# Autodesk Inventor assembly: PneumaticAirCylinder
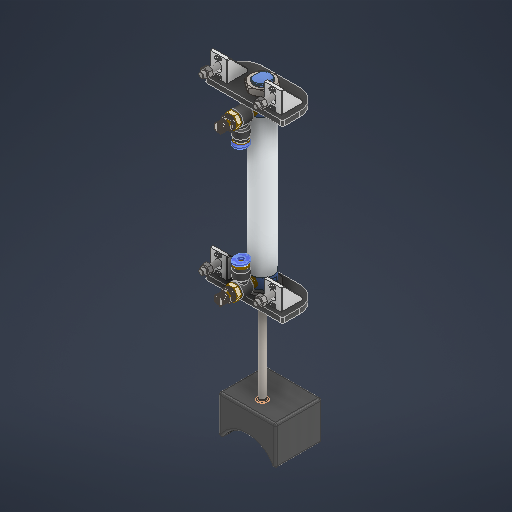
[picture p0: Inventor's stored thumbnail of the model, 512x512]
Saved by Autodesk Inventor 2027.1 (Build 311270010, 270A)
## iProperties
Created: 2026-01-10
Part Number: PneumaticAirCylinder
Description: STEP AP214
Document SubType Name: Assembly
Designer: SDS Scholar
Sending System: SolidWorks 2024
Preprocessor: SwSTEP 2.0
Title: PneumaticAirCylinder.STEP
Author: alejandroge3105@gmail.com
Revision Number: ANY
## Documents named in this file (20)
- C:\Users\Ahmed\Desktop\Fall 26\Design 1 Repo\MCT333_Design_of_Mechatronics_Systems_1\CAD\pnumatic_components\pneumatic_cylinder_double_action_mal16x75\AutodeskInventor\PneumaticAirCylinder.iam
- C:\Users\Ahmed\Desktop\Fall 26\Design 1 Repo\MCT333_Design_of_Mechatronics_Systems_1\CAD\pnumatic_components\pneumatic_cylinder_double_action_mal16x75\AutodeskInventor\AirCylinderBody.ipt
- C:\Users\Ahmed\Desktop\Fall 26\Design 1 Repo\MCT333_Design_of_Mechatronics_Systems_1\CAD\pnumatic_components\pneumatic_cylinder_double_action_mal16x75\AutodeskInventor\AirCylinderAxis.ipt
- C:\Users\Ahmed\Desktop\Fall 26\Design 1 Repo\MCT333_Design_of_Mechatronics_Systems_1\CAD\pnumatic_components\pneumatic_cylinder_double_action_mal16x75\AutodeskInventor\16mm nut.ipt
- C:\Users\Ahmed\Desktop\Fall 26\Design 1 Repo\MCT333_Design_of_Mechatronics_Systems_1\CAD\FEED and Sorting\feeding_mechanism\CylinderEndEffector.ipt
- C:\Users\Ahmed\Desktop\Fall 26\Design 1 Repo\MCT333_Design_of_Mechatronics_Systems_1\CAD\pnumatic_components\pneumatic_flow_control_valve\Flow control\Flow control.ipt
- C:\Users\Ahmed\Desktop\Fall 26\Design 1 Repo\MCT333_Design_of_Mechatronics_Systems_1\CAD\off_the_shelf_components\flanged_inserts\flanged insert M6 D9.5 H14.05.stp.ipt
- C:\Users\Ahmed\Documents\Inventor\Content Center Files\R2027\en-US\ANSI B18.22 M\ANSI B18.22M - 14 N.ipt
- C:\Users\Ahmed\Desktop\Fall 26\Design 1 Repo\MCT333_Design_of_Mechatronics_Systems_1\CAD\pnumatic_components\pneumatic_cylinder_double_action_mal16x75\AutodeskInventor\CornerBracket2020.ipt
- C:\Users\Ahmed\Desktop\Fall 26\Design 1 Repo\MCT333_Design_of_Mechatronics_Systems_1\CAD\pnumatic_components\pneumatic_cylinder_double_action_mal16x75\AutodeskInventor\Cylinder Bracket.ipt
- C:\Users\Ahmed\Documents\Inventor\Content Center Files\R2027\en-US\ISO 4762(2)\ISO 4762 - M5 x 20ISO.ipt
- C:\Users\Ahmed\Documents\Inventor\Content Center Files\R2027\en-US\ISO 4762(2)\ISO 4762 - M5 x 16ISO.ipt
- C:\Users\Ahmed\Documents\Inventor\Content Center Files\R2027\en-US\ISO 4032(2)\ISO 4032 - M5 - ISO.ipt
- flanged insert M6 D9.5 H14.05.stp
- C:\Users\Ahmed\Desktop\Fall 26\Design 1 Repo\MCT333_Design_of_Mechatronics_Systems_1\CAD\pnumatic_components\pneumatic_cylinder_double_action_mal16x75\AutodeskInventor\PneumaticAirCylinder\AIP\FEA\fm4iroszk.fins
- C:\Users\Ahmed\Desktop\Fall 26\Design 1 Repo\MCT333_Design_of_Mechatronics_Systems_1\CAD\pnumatic_components\pneumatic_cylinder_double_action_mal16x75\AutodeskInventor\PneumaticAirCylinder\AIP\FEA\fm4iroszk.fsat
- C:\Users\Ahmed\Desktop\Fall 26\Design 1 Repo\MCT333_Design_of_Mechatronics_Systems_1\CAD\pnumatic_components\pneumatic_cylinder_double_action_mal16x75\AutodeskInventor\PneumaticAirCylinder\AIP\FEA\fm4iroszk.ftes
- C:\Users\Ahmed\Desktop\Fall 26\Design 1 Repo\MCT333_Design_of_Mechatronics_Systems_1\CAD\pnumatic_components\pneumatic_cylinder_double_action_mal16x75\AutodeskInventor\PneumaticAirCylinder\AIP\FEA\fm4iroszk.fwiz
- C:\Users\Ahmed\Desktop\Fall 26\Design 1 Repo\MCT333_Design_of_Mechatronics_Systems_1\CAD\pnumatic_components\pneumatic_cylinder_double_action_mal16x75\AutodeskInventor\PneumaticAirCylinder\AIP\FEA\fm4irot1c.fmsh
- C:\Users\Ahmed\Desktop\Fall 26\Design 1 Repo\MCT333_Design_of_Mechatronics_Systems_1\CAD\pnumatic_components\pneumatic_cylinder_double_action_mal16x75\AutodeskInventor\PneumaticAirCylinder\AIP\FEA\fm4j9jfk0.fres
## Components (32 placed, 13 different names)
1. AirCylinderBody_1 — Mate:1, Mate:2, Mate:5, Mate:6, Mate:8, Mate:11, Mate:9, Mate:10, Mate:19, Mate:25, Mate:36
2. AirCylinderAxis_2 — Mate:5, Mate:6, Mate:7, Mate:13
3. 16mm nut_3 — Mate:1, Mate:2, Mate:38
4. CylinderEndEffector:1 — Mate:7, Angle:1, Angle:2, Mate:12, Flush:14, Mate:13
5. Flow control:1 — Mate:8, Mate:11, Angle:2, Angle:3
6. Flow control:2 — Mate:9, Mate:10, Angle:3
7. flanged insert M6 D9.5 H14.05.stp:1 — Mate:12, Flush:14
8. 16mm nut:2 — Mate:19, Mate:27
9. Plain Washer (Metric) 14 N:1 — Mate:26
10. Plain Washer (Metric) 14 N:2 — Mate:37
11. CornerBracket2020:1 — Mate:28, Flush:15, Mate:29, Insert:1, Insert:13, Mate:47
12. Cylinder Bracket:1 — Mate:25, Mate:26, Mate:27, Angle:4, Mate:28, Flush:15, Mate:29, Mate:30, Flush:16, Mate:31, Flush:19, Insert:7, Insert:8
13. CornerBracket2020:2 — Mate:30, Flush:16, Mate:31, Insert:2, Insert:15, Mate:46
14. CornerBracket2020:3 — Insert:3, Insert:9, Mate:44
15. Cylinder Bracket:2 — Mate:36, Mate:37, Mate:38, Flush:19, Insert:5, Insert:6
16. CornerBracket2020:4 — Insert:4, Insert:11, Mate:45
17. ISO 4762 M5 x 20:2 — Insert:1, Mate:40
18. ISO 4762 M5 x 20:3 — Insert:2, Mate:39
19. ISO 4762 M5 x 20:1 — Insert:3, Mate:43
20. ISO 4762 M5 x 20:4 — Insert:4, Mate:41
21. ISO 4762 M5 x 16:1 — Insert:5
22. ISO 4762 M5 x 16:2 — Insert:6
23. ISO 4762 M5 x 16:4 — Insert:7
24. ISO 4762 M5 x 16:3 — Insert:8
25. ISO 4032 M5:1 — Mate:39, Mate:46
26. ISO 4032 M5:2 — Mate:40, Mate:47
27. ISO 4032 M5:3 — Mate:41, Mate:45
28. ISO 4032 M5:4 — Mate:43, Mate:44
29. ISO 4032 M5:5 — Insert:9
30. ISO 4032 M5:7 — Insert:11
31. ISO 4032 M5:9 — Insert:13
32. ISO 4032 M5:11 — Insert:15
## Relationships (60: Mate 38, Insert 12, Flush 6, Angle 4)
- Mate:1: AirCylinderBody_1 ↔ 16mm nut_3
- Mate:2: AirCylinderBody_1 ↔ 16mm nut_3
- Mate:5: AirCylinderBody_1 ↔ AirCylinderAxis_2
- Mate:6: AirCylinderBody_1 ↔ AirCylinderAxis_2
- Mate:7: AirCylinderAxis_2 ↔ CylinderEndEffector:1
- Angle:1 (0 deg): CylinderEndEffector:1
- Mate:8: AirCylinderBody_1 ↔ Flow control:1
- Mate:11 (5 mm): AirCylinderBody_1 ↔ Flow control:1
- Mate:9: AirCylinderBody_1 ↔ Flow control:2
- Mate:10 (5 mm): AirCylinderBody_1 ↔ Flow control:2
- Angle:2 (0 deg): CylinderEndEffector:1 ↔ Flow control:1
- Angle:3 (180 deg): Flow control:1 ↔ Flow control:2
- Mate:12: CylinderEndEffector:1 ↔ flanged insert M6 D9.5 H14.05.stp:1
- Flush:14: CylinderEndEffector:1 ↔ flanged insert M6 D9.5 H14.05.stp:1
- Mate:13: AirCylinderAxis_2 ↔ CylinderEndEffector:1
- Mate:19: AirCylinderBody_1 ↔ 16mm nut:2
- [Mate]: AirCylinderBody_1 ↔ Plain Washer (Metric) 14 N:2
- [Mate]: AirCylinderBody_1 ↔ Plain Washer (Metric) 14 N:2
- [Mate]: AirCylinderBody_1 ↔ Plain Washer (Metric) 14 N:1
- [Mate]: AirCylinderBody_1 ↔ Plain Washer (Metric) 14 N:1
- Mate:25: AirCylinderBody_1 ↔ Cylinder Bracket:1
- Mate:26: Plain Washer (Metric) 14 N:1 ↔ Cylinder Bracket:1
- Mate:27: 16mm nut:2 ↔ Cylinder Bracket:1
- Angle:4 (0 deg): Cylinder Bracket:1
- Mate:28: CornerBracket2020:1 ↔ Cylinder Bracket:1
- Flush:15: CornerBracket2020:1 ↔ Cylinder Bracket:1
- Mate:29: CornerBracket2020:1 ↔ Cylinder Bracket:1
- Mate:30: Cylinder Bracket:1 ↔ CornerBracket2020:2
- Flush:16: Cylinder Bracket:1 ↔ CornerBracket2020:2
- Mate:31: Cylinder Bracket:1 ↔ CornerBracket2020:2
- [Mate]: CornerBracket2020:3 ↔ Cylinder Bracket:2
- [Flush]: CornerBracket2020:3 ↔ Cylinder Bracket:2
- [Mate]: CornerBracket2020:3 ↔ Cylinder Bracket:2
- [Mate]: Cylinder Bracket:2 ↔ CornerBracket2020:4
- [Flush]: Cylinder Bracket:2 ↔ CornerBracket2020:4
- [Mate]: Cylinder Bracket:2 ↔ CornerBracket2020:4
- Mate:36: AirCylinderBody_1 ↔ Cylinder Bracket:2
- Mate:37: Plain Washer (Metric) 14 N:2 ↔ Cylinder Bracket:2
- Mate:38: 16mm nut_3 ↔ Cylinder Bracket:2
- Flush:19: Cylinder Bracket:1 ↔ Cylinder Bracket:2
- Insert:1: CornerBracket2020:1 ↔ ISO 4762 M5 x 20:2
- Insert:2: CornerBracket2020:2 ↔ ISO 4762 M5 x 20:3
- Insert:3: CornerBracket2020:3 ↔ ISO 4762 M5 x 20:1
- Insert:4: CornerBracket2020:4 ↔ ISO 4762 M5 x 20:4
- Insert:5: Cylinder Bracket:2 ↔ ISO 4762 M5 x 16:1
- Insert:6: Cylinder Bracket:2 ↔ ISO 4762 M5 x 16:2
- Insert:7: Cylinder Bracket:1 ↔ ISO 4762 M5 x 16:4
- Insert:8: Cylinder Bracket:1 ↔ ISO 4762 M5 x 16:3
- Mate:39: ISO 4762 M5 x 20:3 ↔ ISO 4032 M5:1
- Mate:40: ISO 4762 M5 x 20:2 ↔ ISO 4032 M5:2
- Mate:41: ISO 4762 M5 x 20:4 ↔ ISO 4032 M5:3
- Mate:43: ISO 4762 M5 x 20:1 ↔ ISO 4032 M5:4
- Insert:9: CornerBracket2020:3 ↔ ISO 4032 M5:5
- Insert:11: CornerBracket2020:4 ↔ ISO 4032 M5:7
- Insert:13: CornerBracket2020:1 ↔ ISO 4032 M5:9
- Insert:15: CornerBracket2020:2 ↔ ISO 4032 M5:11
- Mate:44 (7 mm): CornerBracket2020:3 ↔ ISO 4032 M5:4
- Mate:45 (7 mm): CornerBracket2020:4 ↔ ISO 4032 M5:3
- Mate:46 (7 mm): CornerBracket2020:2 ↔ ISO 4032 M5:1
- Mate:47 (7 mm): CornerBracket2020:1 ↔ ISO 4032 M5:2
## Named parameters: d52_d46 = 0 mm, d53_d47 = 0 mm, d54_d48 = 0 mm, d55_d49 = 0 mm, d56_d50 = 0 mm, d57_d51 = 0 mm, sa_0 = 30, sa_1 = 73.6, sa_2 = 73.6, sa_3 = 60
note: some values were not read from the file. Shown as the stored number, unit unknown: "sa_0", "sa_1", "sa_2", "sa_3".
